# Autodesk Inventor assembly: result-insert
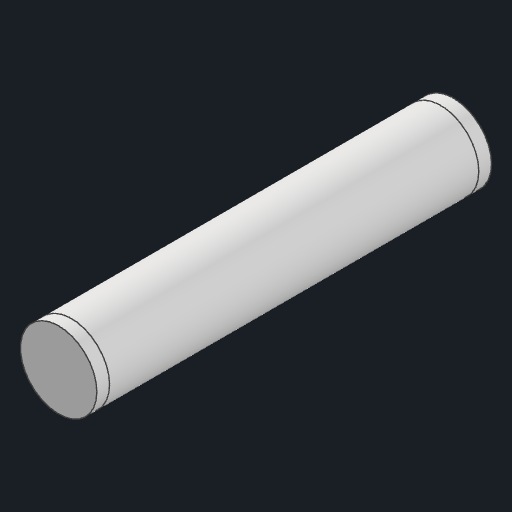
[picture p0: Inventor's stored thumbnail of the model, 512x512]
Saved by Autodesk Inventor 2026.1 (Build 301233000, 233)
## iProperties
Created: 2026-10-30
Part Number: result-insert
Document SubType Name: Assembly
Designer: anony
Author: anony
## Documents named in this file (2)
- C:\Users\anony\OneDrive\Desktop\AI Projects\CAD Convert\corpus\generated\asmimate\result-insert.iam
- C:\Users\anony\OneDrive\Desktop\AI Projects\CAD Convert\corpus\generated\imate\insert.ipt
## Components (2 placed, 1 different names)
1. insert:1 — Insert:1
2. insert:2 — Insert:1
## Relationships (1: Insert 1)
- Insert:1 (1 mm): insert:1 ↔ insert:2
